# Autodesk Inventor assembly: 3x4x2mm_tact_button
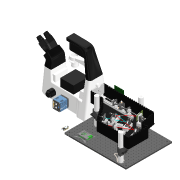
[picture p0: Inventor's stored thumbnail of the model, 180x180]
Saved by Autodesk Inventor 2022.5 (Build 265521000, 521)
## iProperties
Created: 2024-03-14
Part Number: 3x4x2mm_tact_button
Material: Steel
Document SubType Name: Modeling
Designer: wanghaoran
Density: 7.85 g/cm^3
Appearance: Default
Author: wanghaoran
Part Number: ESP32-WROVER-B v1
Part Number: Main PCB
Part Number: zl201-19_p2-54_l48-3_w2-54_h8-9
Created: 2024-03-08
Part Number: ESP32-WROVER-DEVKIT-NODEMCU-V1.3
Document SubType Name: Assembly
Title: ESP32-WROVER-DEVKIT-NODEMCU-V1.3.step
Sending System: Autodesk Translation Framework v12.20.1.177
Preprocessor: ST-DEVELOPER v20
Part Number: ab2_usb_micro_smd.wrl
Part Number: Soldering-Contacts
Created: 2022-04-09
Part Number: Assembly_SIMMO_2
Designer: Prakash Lab
Author: Prakash Lab
## Documents named in this file (45)
- **E:\GitHub\SIMMO\INVENTOR\Assembly_SIMMO_1.iam*LocalDocs*xAaaaacbaAaaaaaaaAaaaaodcAh*3x4x2mm_tact_button.ipt
- **E:\GitHub\SIMMO\INVENTOR\Assembly_SIMMO_1.iam*LocalDocs*xAaaaa0aaAaaaaaaaAaaaamsrAf*ESP32-WROVER-B v1.ipt
- **E:\GitHub\SIMMO\INVENTOR\Assembly_SIMMO_1.iam*LocalDocs*xAaaaq4caAaaaaaaaAaaaahxeNe*Main PCB.ipt
- **E:\GitHub\SIMMO\INVENTOR\Assembly_SIMMO_1.iam*LocalDocs*xAaaaalbaAaaaaaaaAaaaqbcdUb*zl201-19_p2-54_l48-3_w2-54_h8-9.ipt
- **E:\GitHub\SIMMO\INVENTOR\Assembly_SIMMO_1.iam*LocalDocs*xAaaaagdaAaaaaaaaAaaaqh0mQa*ESP32-WROVER-DEVKIT-NODEMCU-V1.3.iam
- **E:\GitHub\SIMMO\INVENTOR\Assembly_SIMMO_1.iam*LocalDocs*xAaaaqlcaAaaaaaaaAaaaakdaUe*Soldering-Contacts.ipt
- **E:\GitHub\SIMMO\INVENTOR\Assembly_SIMMO_1.iam*LocalDocs*xAaaaambaAaaaaaaaAaaaa2232g*ab2_usb_micro_smd.wrl.ipt
- E:\GitHub\SIMMO\INVENTOR\Assembly_SIMMO_1.iam
- E:\GitHub\SIMMO\INVENTOR\00_AC254-200-A-ML-Step.ipt
- E:\GitHub\SIMMO\INVENTOR\Adapter_DMD_KM100.ipt
- E:\GitHub\SIMMO\INVENTOR\Cover_new.ipt
- E:\GitHub\SIMMO\INVENTOR\KM100-Solidworks.ipt
- E:\GitHub\SIMMO\INVENTOR\Nikon_Ti2E.ipt
- E:\GitHub\SIMMO\INVENTOR\00_AC254-030-A-ML-Step.ipt
- E:\GitHub\SIMMO\INVENTOR\00_AC254-075-A-ML-Step.ipt
- E:\GitHub\SIMMO\INVENTOR\00_Beampath_v0.ipt
- E:\GitHub\SIMMO\INVENTOR\00_KM100-Step.ipt
- E:\GitHub\SIMMO\INVENTOR\00_PF10-03-P01-Solidworks.ipt
- E:\GitHub\SIMMO\INVENTOR\00_Baseplate_Simmo_base.ipt
- E:\GitHub\SIMMO\INVENTOR\00_B3060L-Step.ipt
- E:\GitHub\SIMMO\INVENTOR\Assembly_Post_v0.iam
- E:\GitHub\SIMMO\INVENTOR\00_PCO_edge-det.ipt
- E:\GitHub\SIMMO\INVENTOR\00_Aluminium_Extrusion_20x20.ipt
- E:\GitHub\SIMMO\INVENTOR\10_Mountinplate_Mirrors_v0.ipt
- E:\GitHub\SIMMO\INVENTOR\00_Baseplate_Simmo_top.ipt
- E:\GitHub\SIMMO\INVENTOR\MB4560_M-Solidworks.ipt
- E:\GitHub\SIMMO\INVENTOR\00_Baseplate_Simmo_side2_v2.ipt
- E:\GitHub\SIMMO\INVENTOR\10_Baseplate_Simmo_side1.ipt
- E:\GitHub\SIMMO\INVENTOR\00_Aluminium_Extrusion_20x20_250mm.ipt
- E:\GitHub\SIMMO\INVENTOR\00_CP33_M-Solidworks.ipt
- E:\GitHub\SIMMO\INVENTOR\00_Baseplate_Simmo_side5_v2.ipt
- E:\GitHub\SIMMO\INVENTOR\00_Baseplate_Simmo_side6_v2.ipt
- E:\GitHub\SIMMO\INVENTOR\00_Baseplate_Simmo_side7_v2.ipt
- E:\GitHub\SIMMO\INVENTOR\00_Baseplate_Simmo_side4_v2.ipt
- E:\GitHub\SIMMO\INVENTOR\MCH008_EVM_BOARD.ipt
- E:\GitHub\SIMMO\INVENTOR\MCH011_FLASH_BOARD.ipt
- E:\GitHub\SIMMO\INVENTOR\NikonStativ\Nikon_Eclipse_Ts2R_FL_Assy.ipt
- E:\GitHub\SIMMO\INVENTOR\00_Laser_HeatSink.ipt
- E:\GitHub\SIMMO\INVENTOR\00_Baseplate_Simmo_side3_v2.ipt
- E:\WeChat Files\WeChat Files\wanghaoran2558\FileStorage\File\2023-12\Raspberry_Pi_3.ipt
- E:\GitHub\SIMMO\INVENTOR\30126G3-Solidworks.ipt
- E:\GitHub\SIMMO\INVENTOR\CXY1QA-Solidworks.ipt
- E:\GitHub\SIMMO\INVENTOR\RailOptiX_Thorlabs.ipt
- E:\GitHub\SIMMO\INVENTOR\rpi2-top_netfabb.ipt
- E:\GitHub\SIMMO\INVENTOR\rpi3-bottom_100mm-vesa_netfabb.ipt
## Components (66 placed, 38 different names)
1. Adapter_DMD_KM100:1 — Insert:5, Mate:5, Insert:6
2. KM100-Solidworks:1 — Insert:6, Angle:3, Einfügen:35, Winkel:12
3. Nikon_Ti2E:1 — Mate:1, Mate:2, Mate:3, Flush:1, Flush:2, Angle:6, Fluchtend:7, Passend:25, Passend:26, Mate:32, Passend:33, Mate:43, Insert:53, Angle:27
4. 00_Beampath_v0:1 — Flush:1, Flush:2, Insert:1, Insert:3, Angle:1, Insert:23, Insert:25, Insert:27, Insert:29, Passend:33, Mate:50, Mate:52
5. 00_AC254-200-A-ML-Step:1 — Insert:1
6. 00_AC254-075-A-ML-Step:2 — Insert:3, Insert:45
7. Cover_new:1 — Angle:1, Angle:2, Insert:5, Mate:5, Insert:50, Insert:51
8. 00_KM100-Step:2 — Insert:16, Angle:8, Einfügen:33, Winkel:10
9. 00_KM100-Step:3 — Insert:14, Angle:6, Einfügen:34, Winkel:11
10. 00_PF10-03-P01-Solidworks:1 — Insert:14
11. 00_PF10-03-P01-Solidworks:2 — Insert:16, Insert:23
12. 00_KM100-Step:5 — Insert:21, Angle:9
13. 00_PF10-03-P01-Solidworks:3 — Insert:21, Insert:25
14. 00_AC254-030-A-ML-Step:2 — Insert:27, Flush:29, Insert:42
15. 00_Aluminium_Extrusion_20x20:1 — Passend:24, Passend:25, Passend:26, Mate:75, Flush:41, Flush:42, Mate:76, Flush:43, Flush:44, Mate:77, Flush:45, Flush:46
16. 00_AC254-030-A-ML-Step:3 — Insert:29, Flush:30, Insert:48
17. 00_Baseplate_Simmo_base:1 — Fluchtend:7, Angle:8, Angle:9, Passend:24, Mate:43, Mate:47, Flush:25, Flush:26, Mate:49, Mate:51, Flush:31, Flush:32, Flush:33, Flush:34, Insert:54, Insert:55, Insert:56, Insert:57, Insert:58, Insert:59 …
18. 10_Mountinplate_Mirrors_v0:1 — Mate:90, Mate:91, Mate:92
19. 10_Mountinplate_Mirrors_v0:2 — Einfügen:33, Winkel:10
20. 10_Mountinplate_Mirrors_v0:3 — Einfügen:34, Winkel:11, Insert:54, Mate:82
21. 10_Mountinplate_Mirrors_v0:4 — Einfügen:35, Winkel:12, Insert:55, Mate:93
22. 00_AC254-075-A-ML-Step:3 — Mate:32, Insert:43
23. Assembly_Post_v0:2 [sub-assembly] — Mate:47
24. Assembly_Post_v0:3 [sub-assembly]
25. 00_Baseplate_Simmo_top:1
26. MB4560_M-Solidworks:1 — Mate:55, Flush:37, Angle:27, Mate:87, Mate:88, Flush:57, Mate:89
27. 00_Baseplate_Simmo_side2_v2:1 — Flush:25
28. 00_Baseplate_Simmo_side1:1 — Flush:26, Mate:56, Flush:38, Flush:39
29. 00_Aluminium_Extrusion_20x20_250mm:1 — Mate:49, Mate:50, Flush:29, Angle:17, Mate:79, Flush:49, Flush:50, Mate:81, Flush:53, Flush:54
30. 00_Aluminium_Extrusion_20x20_250mm:2 — Mate:51, Mate:52, Flush:30, Angle:25, Mate:78, Flush:47, Flush:48, Mate:80, Flush:51, Flush:52
31. 00_CP33_M-Solidworks:2 — Angle:17, Mate:69
32. 00_CP33_M-Solidworks:3 — Insert:45
33. 00_CP33_M-Solidworks:4 — Insert:42
34. 00_CP33_M-Solidworks:5 — Insert:43
35. 00_CP33_M-Solidworks:7 — Insert:48
36. 00_CP33_M-Solidworks:8 — Angle:25, Mate:66
37. 00_Baseplate_Simmo_side5_v2:1 — Flush:31
38. 00_Baseplate_Simmo_side6_v2:1 — Flush:32
39. Assembly_Post_v0:4 [sub-assembly]
40. 00_Baseplate_Simmo_side7_v2:1 — Flush:33
41. 00_Baseplate_Simmo_side4_v2:1 — Flush:34
42. MCH008_EVM_BOARD:1 — Mate:56, Flush:38, Flush:39
43. MCH011_FLASH_BOARD:1 — Insert:50, Insert:51
44. Nikon_Eclipse_Ts2R_FL_Assy:1 — Insert:52, Angle:26, Mate:55, Flush:37, Insert:53
45. 00_PCO_edge-det:3 — Insert:52, Angle:26, Flush:57
46. 00_Laser_HeatSink:1 — Insert:56, Insert:57
47. 00_Laser_HeatSink:2 — Insert:58, Insert:59
48. 00_Baseplate_Simmo_side3_v2:1 — Flush:40
49. Raspberry_Pi_3:1 — Mate:83, Mate:84, Mate:85
50. 30126G3-Solidworks:1 — Mate:69
51. 30126G3-Solidworks:2 — Mate:66
52. CXY1QA-Solidworks:1 — Mate:72, Angle:28, Mate:73, Mate:74
53. RailOptiX_Thorlabs:1 — Mate:72, Angle:28, Mate:73, Mate:74, Mate:75, Flush:41, Flush:42
54. RailOptiX_Thorlabs:2 — Mate:76, Flush:43, Flush:44
55. RailOptiX_Thorlabs:3 — Mate:78, Flush:47, Flush:48
56. RailOptiX_Thorlabs:4 — Mate:77, Flush:45, Flush:46
57. RailOptiX_Thorlabs:5 — Mate:80, Flush:51, Flush:52
58. RailOptiX_Thorlabs:6 — Mate:81, Flush:53, Flush:54
59. RailOptiX_Thorlabs:7 — Mate:79, Flush:49, Flush:50
60. rpi2-top_netfabb:1 — Mate:86, Flush:55, Flush:56
61. rpi3-bottom_100mm-vesa_netfabb:1 — Mate:83, Mate:84, Mate:85, Mate:86, Flush:55, Flush:56, Mate:87, Mate:88, Mate:89
62. ESP32-WROVER-DEVKIT-NODEMCU-V1.3:1 [sub-assembly]
63. 00_B3060L-Step:1
64. 00_B3060L-Step:2
65. 00_B3060L-Step:3
66. 00_B3060L-Step:4
## Relationships (115: Mate 41, Flush 32, Insert 28, Angle 14)
- Mate:1: Nikon_Ti2E:1
- Mate:2: Nikon_Ti2E:1
- Mate:3: Nikon_Ti2E:1
- Flush:1: Nikon_Ti2E:1 ↔ 00_Beampath_v0:1
- Flush:2: Nikon_Ti2E:1 ↔ 00_Beampath_v0:1
- Insert:1: 00_Beampath_v0:1 ↔ 00_AC254-200-A-ML-Step:1
- Insert:3: 00_Beampath_v0:1 ↔ 00_AC254-075-A-ML-Step:2
- Angle:1: 00_Beampath_v0:1 ↔ Cover_new:1
- Angle:2: Cover_new:1
- Insert:5: Adapter_DMD_KM100:1 ↔ Cover_new:1
- Mate:5: Adapter_DMD_KM100:1 ↔ Cover_new:1
- Insert:6: Adapter_DMD_KM100:1 ↔ KM100-Solidworks:1
- Angle:3: KM100-Solidworks:1
- Insert:14: 00_KM100-Step:3 ↔ 00_PF10-03-P01-Solidworks:1
- Angle:6: Nikon_Ti2E:1 ↔ 00_KM100-Step:3
- Insert:16: 00_KM100-Step:2 ↔ 00_PF10-03-P01-Solidworks:2
- Fluchtend:7 [Flush]: Nikon_Ti2E:1 ↔ 00_Baseplate_Simmo_base:1
- Insert:21: 00_KM100-Step:5 ↔ 00_PF10-03-P01-Solidworks:3
- Insert:23: 00_Beampath_v0:1 ↔ 00_PF10-03-P01-Solidworks:2
- Insert:25: 00_Beampath_v0:1 ↔ 00_PF10-03-P01-Solidworks:3
- Insert:27: 00_Beampath_v0:1 ↔ 00_AC254-030-A-ML-Step:2
- Angle:8: 00_KM100-Step:2 ↔ 00_Baseplate_Simmo_base:1
- Angle:9: 00_KM100-Step:5 ↔ 00_Baseplate_Simmo_base:1
- Passend:24 [Mate]: 00_Aluminium_Extrusion_20x20:1 ↔ 00_Baseplate_Simmo_base:1
- Passend:25 [Mate]: Nikon_Ti2E:1 ↔ 00_Aluminium_Extrusion_20x20:1
- Passend:26 [Mate]: Nikon_Ti2E:1 ↔ 00_Aluminium_Extrusion_20x20:1
- Insert:29: 00_Beampath_v0:1 ↔ 00_AC254-030-A-ML-Step:3
- Einfügen:33 [Insert]: 00_KM100-Step:2 ↔ 10_Mountinplate_Mirrors_v0:2
- Winkel:10 [Angle]: 00_KM100-Step:2 ↔ 10_Mountinplate_Mirrors_v0:2
- Einfügen:34 [Insert]: 00_KM100-Step:3 ↔ 10_Mountinplate_Mirrors_v0:3
- Winkel:11 [Angle]: 00_KM100-Step:3 ↔ 10_Mountinplate_Mirrors_v0:3
- Einfügen:35 [Insert]: KM100-Solidworks:1 ↔ 10_Mountinplate_Mirrors_v0:4
- Winkel:12 [Angle]: KM100-Solidworks:1 ↔ 10_Mountinplate_Mirrors_v0:4
- Mate:32: Nikon_Ti2E:1 ↔ 00_AC254-075-A-ML-Step:3
- Passend:33 [Mate]: Nikon_Ti2E:1 ↔ 00_Beampath_v0:1
- Mate:43: Nikon_Ti2E:1 ↔ 00_Baseplate_Simmo_base:1
- Mate:47: 00_Baseplate_Simmo_base:1 ↔ Assembly_Post_v0:2
- Flush:25: 00_Baseplate_Simmo_base:1 ↔ 00_Baseplate_Simmo_side2_v2:1
- Flush:26: 00_Baseplate_Simmo_base:1 ↔ 00_Baseplate_Simmo_side1:1
- Mate:49: 00_Baseplate_Simmo_base:1 ↔ 00_Aluminium_Extrusion_20x20_250mm:1
- Mate:50: 00_Beampath_v0:1 ↔ 00_Aluminium_Extrusion_20x20_250mm:1
- Flush:29: 00_AC254-030-A-ML-Step:2 ↔ 00_Aluminium_Extrusion_20x20_250mm:1
- Mate:51: 00_Baseplate_Simmo_base:1 ↔ 00_Aluminium_Extrusion_20x20_250mm:2
- Mate:52: 00_Beampath_v0:1 ↔ 00_Aluminium_Extrusion_20x20_250mm:2
- Flush:30: 00_AC254-030-A-ML-Step:3 ↔ 00_Aluminium_Extrusion_20x20_250mm:2
- Angle:17: 00_Aluminium_Extrusion_20x20_250mm:1 ↔ 00_CP33_M-Solidworks:2
- Insert:42: 00_AC254-030-A-ML-Step:2 ↔ 00_CP33_M-Solidworks:4
- Insert:43: 00_AC254-075-A-ML-Step:3 ↔ 00_CP33_M-Solidworks:5
- Insert:45: 00_AC254-075-A-ML-Step:2 ↔ 00_CP33_M-Solidworks:3
- Insert:48: 00_AC254-030-A-ML-Step:3 ↔ 00_CP33_M-Solidworks:7
- Angle:25: 00_Aluminium_Extrusion_20x20_250mm:2 ↔ 00_CP33_M-Solidworks:8
- Flush:31: 00_Baseplate_Simmo_base:1 ↔ 00_Baseplate_Simmo_side5_v2:1
- Flush:32: 00_Baseplate_Simmo_base:1 ↔ 00_Baseplate_Simmo_side6_v2:1
- Flush:33: 00_Baseplate_Simmo_base:1 ↔ 00_Baseplate_Simmo_side7_v2:1
- Flush:34: 00_Baseplate_Simmo_base:1 ↔ 00_Baseplate_Simmo_side4_v2:1
- Insert:50: Cover_new:1 ↔ MCH011_FLASH_BOARD:1
- Insert:51: Cover_new:1 ↔ MCH011_FLASH_BOARD:1
- Insert:52: Nikon_Eclipse_Ts2R_FL_Assy:1 ↔ 00_PCO_edge-det:3
- Angle:26: Nikon_Eclipse_Ts2R_FL_Assy:1 ↔ 00_PCO_edge-det:3
- Mate:55: MB4560_M-Solidworks:1 ↔ Nikon_Eclipse_Ts2R_FL_Assy:1
- Flush:37: MB4560_M-Solidworks:1 ↔ Nikon_Eclipse_Ts2R_FL_Assy:1
- Insert:53: Nikon_Ti2E:1 ↔ Nikon_Eclipse_Ts2R_FL_Assy:1
- Angle:27: Nikon_Ti2E:1 ↔ MB4560_M-Solidworks:1
- Insert:54: 00_Baseplate_Simmo_base:1 ↔ 10_Mountinplate_Mirrors_v0:3
- Insert:55: 00_Baseplate_Simmo_base:1 ↔ 10_Mountinplate_Mirrors_v0:4
- Insert:56: 00_Baseplate_Simmo_base:1 ↔ 00_Laser_HeatSink:1
- Insert:57: 00_Baseplate_Simmo_base:1 ↔ 00_Laser_HeatSink:1
- Insert:58: 00_Baseplate_Simmo_base:1 ↔ 00_Laser_HeatSink:2
- Insert:59: 00_Baseplate_Simmo_base:1 ↔ 00_Laser_HeatSink:2
- Mate:56: 00_Baseplate_Simmo_side1:1 ↔ MCH008_EVM_BOARD:1
- Flush:38: 00_Baseplate_Simmo_side1:1 ↔ MCH008_EVM_BOARD:1
- Flush:39: 00_Baseplate_Simmo_side1:1 ↔ MCH008_EVM_BOARD:1
- Flush:40: 00_Baseplate_Simmo_base:1 ↔ 00_Baseplate_Simmo_side3_v2:1
- Mate:66: 00_CP33_M-Solidworks:8 ↔ 30126G3-Solidworks:2
- Mate:69: 00_CP33_M-Solidworks:2 ↔ 30126G3-Solidworks:1
- Mate:72: CXY1QA-Solidworks:1 ↔ RailOptiX_Thorlabs:1
- Angle:28: CXY1QA-Solidworks:1 ↔ RailOptiX_Thorlabs:1
- Mate:73: CXY1QA-Solidworks:1 ↔ RailOptiX_Thorlabs:1
- Mate:74: CXY1QA-Solidworks:1 ↔ RailOptiX_Thorlabs:1
- Mate:75: 00_Aluminium_Extrusion_20x20:1 ↔ RailOptiX_Thorlabs:1
- Flush:41: 00_Aluminium_Extrusion_20x20:1 ↔ RailOptiX_Thorlabs:1
- Flush:42: 00_Aluminium_Extrusion_20x20:1 ↔ RailOptiX_Thorlabs:1
- Mate:76: 00_Aluminium_Extrusion_20x20:1 ↔ RailOptiX_Thorlabs:2
- Flush:43: 00_Aluminium_Extrusion_20x20:1 ↔ RailOptiX_Thorlabs:2
- Flush:44: 00_Aluminium_Extrusion_20x20:1 ↔ RailOptiX_Thorlabs:2
- Mate:77: 00_Aluminium_Extrusion_20x20:1 ↔ RailOptiX_Thorlabs:4
- Flush:45: 00_Aluminium_Extrusion_20x20:1 ↔ RailOptiX_Thorlabs:4
- Flush:46: 00_Aluminium_Extrusion_20x20:1 ↔ RailOptiX_Thorlabs:4
- Mate:78: 00_Aluminium_Extrusion_20x20_250mm:2 ↔ RailOptiX_Thorlabs:3
- Flush:47: 00_Aluminium_Extrusion_20x20_250mm:2 ↔ RailOptiX_Thorlabs:3
- Flush:48: 00_Aluminium_Extrusion_20x20_250mm:2 ↔ RailOptiX_Thorlabs:3
- Mate:79: 00_Aluminium_Extrusion_20x20_250mm:1 ↔ RailOptiX_Thorlabs:7
- Flush:49: 00_Aluminium_Extrusion_20x20_250mm:1 ↔ RailOptiX_Thorlabs:7
- Flush:50: 00_Aluminium_Extrusion_20x20_250mm:1 ↔ RailOptiX_Thorlabs:7
- Mate:80: 00_Aluminium_Extrusion_20x20_250mm:2 ↔ RailOptiX_Thorlabs:5
- Flush:51: 00_Aluminium_Extrusion_20x20_250mm:2 ↔ RailOptiX_Thorlabs:5
- Flush:52: 00_Aluminium_Extrusion_20x20_250mm:2 ↔ RailOptiX_Thorlabs:5
- Mate:81: 00_Aluminium_Extrusion_20x20_250mm:1 ↔ RailOptiX_Thorlabs:6
- Flush:53: 00_Aluminium_Extrusion_20x20_250mm:1 ↔ RailOptiX_Thorlabs:6
- Flush:54: 00_Aluminium_Extrusion_20x20_250mm:1 ↔ RailOptiX_Thorlabs:6
- Mate:82: 00_Baseplate_Simmo_base:1 ↔ 10_Mountinplate_Mirrors_v0:3
- Mate:83: Raspberry_Pi_3:1 ↔ rpi3-bottom_100mm-vesa_netfabb:1
- Mate:84: Raspberry_Pi_3:1 ↔ rpi3-bottom_100mm-vesa_netfabb:1
- Mate:85: Raspberry_Pi_3:1 ↔ rpi3-bottom_100mm-vesa_netfabb:1
- Mate:86: rpi2-top_netfabb:1 ↔ rpi3-bottom_100mm-vesa_netfabb:1
- Flush:55: rpi2-top_netfabb:1 ↔ rpi3-bottom_100mm-vesa_netfabb:1
- Flush:56: rpi2-top_netfabb:1 ↔ rpi3-bottom_100mm-vesa_netfabb:1
- Mate:87: MB4560_M-Solidworks:1 ↔ rpi3-bottom_100mm-vesa_netfabb:1
- Mate:88: MB4560_M-Solidworks:1 ↔ rpi3-bottom_100mm-vesa_netfabb:1
- Flush:57: MB4560_M-Solidworks:1 ↔ 00_PCO_edge-det:3
- Mate:89: MB4560_M-Solidworks:1 ↔ rpi3-bottom_100mm-vesa_netfabb:1
- Mate:90: 00_Baseplate_Simmo_base:1 ↔ 10_Mountinplate_Mirrors_v0:1
- Mate:91: 00_Baseplate_Simmo_base:1 ↔ 10_Mountinplate_Mirrors_v0:1
- Mate:92: 00_Baseplate_Simmo_base:1 ↔ 10_Mountinplate_Mirrors_v0:1
- Mate:93: 00_Baseplate_Simmo_base:1 ↔ 10_Mountinplate_Mirrors_v0:4
